# Autodesk Inventor assembly: GR Master
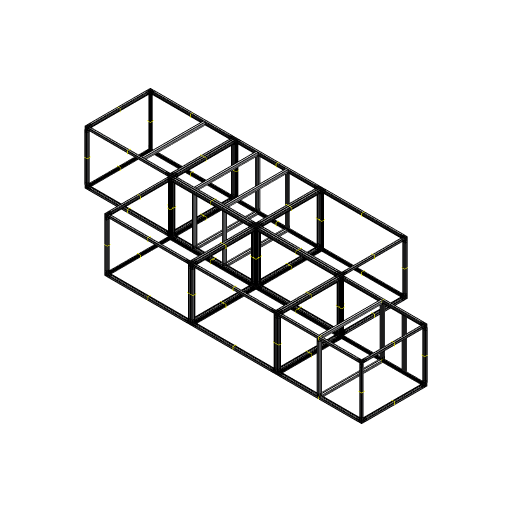
[picture p0: Inventor's stored thumbnail of the model, 512x512]
Saved by Autodesk Inventor 2024.3 (Build 283343000, 343)
## iProperties
Created: 2026-11-19
Part Number: GR Master
Material: Generisch
Document SubType Name: Assembly
Designer: Loay Azzeh
Mass: 149819 g
Surface Area: 673743 cm^2
Volume: 59984.3 cm^3
Density: 2.49763 g/cm^3
Author: Loay Azzeh
## Documents named in this file (8)
- C:\Users\la\Documents\GitHub\Inventor_Sizer\C# Version\GR\20trail20.iam
- C:\Users\la\Documents\GitHub\Inventor_Sizer\APS Ecke Kunststoff.ipt
- C:\Users\la\Documents\GitHub\Inventor_Sizer\Joint.ipt
- C:\Users\la\Documents\GitHub\Inventor_Sizer\P150 2000mm.ipt
- C:\Users\la\Documents\GitHub\Inventor_Sizer\P150 1200mm.ipt
- C:\Users\la\Documents\GitHub\Inventor_Sizer\P150 1500mm.ipt
- C:\Users\la\Documents\GitHub\Inventor_Sizer\P350 1210mm.ipt
- C:\Users\la\Documents\GitHub\Inventor_Sizer\P350 1550mm gefräst.ipt
## Components (146 placed, 7 different names)
1. APS Ecke Kunststoff:1 — Mate:1, Flush:1, Flush:2, Mate:2, Flush:3, Flush:4, Flush:5, Flush:6, Mate:3, Mate:56, Flush:129, Flush:130
2. Joint:1 — Mate:20, Flush:49, Flush:50, Flush:51
3. P150 2000mm:1 — Mate:1, Flush:1, Flush:2, Mate:7, Flush:13, Flush:14, Flush:70, Mate:35, Flush:77, Flush:79, Mate:36
4. P350 1550mm gefräst:1 — Mate:34, Flush:75, Flush:76
5. P350 1210mm:1 — Mate:20, Flush:49, Flush:50, Flush:51, Mate:21, Flush:52, Flush:53, Flush:54, Mate:23, Flush:74, Flush:76, Flush:78
6. P150 1200mm:1 — Mate:2, Flush:3, Flush:4, Mate:23, Mate:31
7. P150 1500mm:1 — Flush:5, Flush:6, Mate:3, Flush:15, Flush:16, Mate:8
8. APS Ecke Kunststoff:2
9. P150 2000mm:2 — Flush:17, Flush:18, Mate:33
10. P150 1200mm:2
11. P150 1500mm:2 — Flush:19, Flush:20
12. APS Ecke Kunststoff:3 — Flush:15, Flush:16, Mate:8, Flush:17, Flush:18, Flush:47, Flush:48
13. APS Ecke Kunststoff:4 — Mate:7, Flush:13, Flush:14, Flush:19, Flush:20, Mate:19, Flush:45, Flush:46, Mate:75, Flush:177, Flush:178
14. APS Ecke Kunststoff:5
15. P150 2000mm:3 — Mate:32, Flush:71, Flush:73, Flush:75, Flush:82
16. P150 1200mm:3 — Flush:47, Flush:48
17. P150 1500mm:3
18. APS Ecke Kunststoff:6
19. P150 2000mm:4 — Mate:22, Flush:54, Mate:30, Mate:34, Mate:37
20. P150 1200mm:4 — Mate:19, Flush:45, Flush:46
21. P150 1500mm:4
22. APS Ecke Kunststoff:7
23. APS Ecke Kunststoff:8
24. Joint:2 — Mate:21, Flush:52, Flush:53, Mate:22
25. Joint:3
26. P350 1210mm:2 — Flush:70, Mate:31, Flush:72, Flush:80
27. Joint:4 — Mate:30
28. Joint:5
29. P350 1210mm:3 — Flush:73, Flush:74
30. Joint:6 — Mate:33
31. Joint:7
32. P350 1210mm:4 — Flush:71, Flush:72, Flush:81
33. Joint:8 — Mate:32
34. P350 1550mm gefräst:2 — Flush:81, Flush:82, Mate:37
35. P350 1550mm gefräst:3 — Mate:35, Flush:77, Flush:78
36. P350 1550mm gefräst:4 — Flush:79, Mate:36, Flush:80
37. APS Ecke Kunststoff:9 — Mate:38, Flush:83, Flush:84, Mate:39, Flush:85, Flush:86, Flush:87, Flush:88, Mate:40
38. P150 2000mm:5 — Mate:38, Flush:83, Flush:84, Mate:44, Flush:95, Flush:96
39. P150 1200mm:5 — Mate:39, Flush:85, Flush:86
40. P150 1500mm:5 — Flush:87, Flush:88, Mate:40, Flush:97, Flush:98, Mate:45
41. APS Ecke Kunststoff:10 — Mate:41, Flush:89, Flush:90, Mate:42, Flush:91, Flush:92, Flush:93, Flush:94, Mate:43
42. P150 2000mm:6 — Mate:41, Flush:89, Flush:90, Flush:99, Flush:100
43. P150 1200mm:6 — Mate:42, Flush:91, Flush:92
44. P150 1500mm:6 — Flush:93, Flush:94, Mate:43, Flush:101, Flush:102
45. APS Ecke Kunststoff:11 — Flush:97, Flush:98, Mate:45, Flush:99, Flush:100, Flush:127, Flush:128
46. APS Ecke Kunststoff:12 — Mate:44, Flush:95, Flush:96, Flush:101, Flush:102, Mate:55, Flush:125, Flush:126, Mate:56, Flush:129, Flush:130
47. APS Ecke Kunststoff:13 — Mate:46, Flush:103, Flush:104, Mate:47, Flush:105, Flush:106, Flush:107, Flush:108, Mate:48
48. P150 2000mm:7 — Mate:46, Flush:103, Flush:104, Mate:52, Flush:115, Flush:116
49. P150 1200mm:7 — Mate:47, Flush:105, Flush:106, Flush:127, Flush:128
50. P150 1500mm:7 — Flush:107, Flush:108, Mate:48, Flush:117, Flush:118, Mate:53
51. APS Ecke Kunststoff:14 — Mate:49, Flush:109, Flush:110, Mate:50, Flush:111, Flush:112, Flush:113, Flush:114, Mate:51, Flush:123, Flush:124
52. P150 2000mm:8 — Mate:49, Flush:109, Flush:110, Mate:54, Flush:119, Flush:120
53. P150 1200mm:8 — Mate:50, Flush:111, Flush:112, Flush:123, Flush:124, Mate:55, Flush:125, Flush:126
54. P150 1500mm:8 — Flush:113, Flush:114, Mate:51, Flush:121, Flush:122
55. APS Ecke Kunststoff:15 — Flush:117, Flush:118, Mate:53, Mate:54, Flush:119, Flush:120
56. APS Ecke Kunststoff:16 — Mate:52, Flush:115, Flush:116, Flush:121, Flush:122
57. APS Ecke Kunststoff:17 — Mate:57, Flush:131, Flush:132, Mate:58, Flush:133, Flush:134, Flush:135, Flush:136, Mate:59, Mate:75, Flush:177, Flush:178, Mate:94, Flush:225, Flush:226
58. P150 2000mm:9 — Mate:57, Flush:131, Flush:132, Mate:63, Flush:143, Flush:144
59. P150 1200mm:9 — Mate:58, Flush:133, Flush:134
60. P150 1500mm:9 — Flush:135, Flush:136, Mate:59, Flush:145, Flush:146, Mate:64
61. APS Ecke Kunststoff:18 — Mate:60, Flush:137, Flush:138, Mate:61, Flush:139, Flush:140, Flush:141, Flush:142, Mate:62
62. P150 2000mm:10 — Mate:60, Flush:137, Flush:138, Flush:147, Flush:148
63. P150 1200mm:10 — Mate:61, Flush:139, Flush:140
64. P150 1500mm:10 — Flush:141, Flush:142, Mate:62, Flush:149, Flush:150
65. APS Ecke Kunststoff:19 — Flush:145, Flush:146, Mate:64, Flush:147, Flush:148, Flush:175, Flush:176
66. APS Ecke Kunststoff:20 — Mate:63, Flush:143, Flush:144, Flush:149, Flush:150, Mate:74, Flush:173, Flush:174
67. APS Ecke Kunststoff:21 — Mate:65, Flush:151, Flush:152, Mate:66, Flush:153, Flush:154, Flush:155, Flush:156, Mate:67
68. P150 2000mm:11 — Mate:65, Flush:151, Flush:152, Mate:71, Flush:163, Flush:164
69. P150 1200mm:11 — Mate:66, Flush:153, Flush:154, Flush:175, Flush:176
70. P150 1500mm:11 — Flush:155, Flush:156, Mate:67, Flush:165, Flush:166, Mate:72
71. APS Ecke Kunststoff:22 — Mate:68, Flush:157, Flush:158, Mate:69, Flush:159, Flush:160, Flush:161, Flush:162, Mate:70, Flush:171, Flush:172
72. P150 2000mm:12 — Mate:68, Flush:157, Flush:158, Mate:73, Flush:167, Flush:168
73. P150 1200mm:12 — Mate:69, Flush:159, Flush:160, Flush:171, Flush:172, Mate:74, Flush:173, Flush:174
74. P150 1500mm:12 — Flush:161, Flush:162, Mate:70, Flush:169, Flush:170
75. APS Ecke Kunststoff:23 — Flush:165, Flush:166, Mate:72, Mate:73, Flush:167, Flush:168
76. APS Ecke Kunststoff:24 — Mate:71, Flush:163, Flush:164, Flush:169, Flush:170
77. APS Ecke Kunststoff:25 — Mate:76, Flush:179, Flush:180, Mate:77, Flush:181, Flush:182, Flush:183, Flush:184, Mate:78, Mate:132, Flush:321, Flush:322
78. P150 2000mm:13 — Mate:76, Flush:179, Flush:180, Mate:82, Flush:191, Flush:192
79. P150 1200mm:13 — Mate:77, Flush:181, Flush:182
80. P150 1500mm:13 — Flush:183, Flush:184, Mate:78, Flush:193, Flush:194, Mate:83
81. APS Ecke Kunststoff:26 — Mate:79, Flush:185, Flush:186, Mate:80, Flush:187, Flush:188, Flush:189, Flush:190, Mate:81
82. P150 2000mm:14 — Mate:79, Flush:185, Flush:186, Flush:195, Flush:196
83. P150 1200mm:14 — Mate:80, Flush:187, Flush:188
84. P150 1500mm:14 — Flush:189, Flush:190, Mate:81, Flush:197, Flush:198
85. APS Ecke Kunststoff:27 — Flush:193, Flush:194, Mate:83, Flush:195, Flush:196, Flush:223, Flush:224, Mate:94, Flush:225, Flush:226
86. APS Ecke Kunststoff:28 — Mate:82, Flush:191, Flush:192, Flush:197, Flush:198, Mate:93, Flush:221, Flush:222, Mate:113, Flush:273, Flush:274
87. APS Ecke Kunststoff:29 — Mate:84, Flush:199, Flush:200, Mate:85, Flush:201, Flush:202, Flush:203, Flush:204, Mate:86
88. P150 2000mm:15 — Mate:84, Flush:199, Flush:200, Mate:90, Flush:211, Flush:212
89. P150 1200mm:15 — Mate:85, Flush:201, Flush:202, Flush:223, Flush:224
90. P150 1500mm:15 — Flush:203, Flush:204, Mate:86, Flush:213, Flush:214, Mate:91
91. APS Ecke Kunststoff:30 — Mate:87, Flush:205, Flush:206, Mate:88, Flush:207, Flush:208, Flush:209, Flush:210, Mate:89, Flush:219, Flush:220
92. P150 2000mm:16 — Mate:87, Flush:205, Flush:206, Mate:92, Flush:215, Flush:216
93. P150 1200mm:16 — Mate:88, Flush:207, Flush:208, Flush:219, Flush:220, Mate:93, Flush:221, Flush:222
94. P150 1500mm:16 — Flush:209, Flush:210, Mate:89, Flush:217, Flush:218
95. APS Ecke Kunststoff:31 — Flush:213, Flush:214, Mate:91, Mate:92, Flush:215, Flush:216
96. APS Ecke Kunststoff:32 — Mate:90, Flush:211, Flush:212, Flush:217, Flush:218
97. APS Ecke Kunststoff:33 — Mate:95, Flush:227, Flush:228, Mate:96, Flush:229, Flush:230, Flush:231, Flush:232, Mate:97, Mate:113, Flush:273, Flush:274
98. P150 2000mm:17 — Mate:95, Flush:227, Flush:228, Mate:101, Flush:239, Flush:240, Mate:141, Flush:338
99. P150 1200mm:17 — Mate:96, Flush:229, Flush:230, Mate:136
100. P150 1500mm:17 — Flush:231, Flush:232, Mate:97, Flush:241, Flush:242, Mate:102
101. APS Ecke Kunststoff:34 — Mate:98, Flush:233, Flush:234, Mate:99, Flush:235, Flush:236, Flush:237, Flush:238, Mate:100
102. P150 2000mm:18 — Mate:98, Flush:233, Flush:234, Flush:243, Flush:244, Mate:139
103. P150 1200mm:18 — Mate:99, Flush:235, Flush:236
104. P150 1500mm:18 — Flush:237, Flush:238, Mate:100, Flush:245, Flush:246
105. APS Ecke Kunststoff:35 — Flush:241, Flush:242, Mate:102, Flush:243, Flush:244, Flush:271, Flush:272
106. APS Ecke Kunststoff:36 — Mate:101, Flush:239, Flush:240, Flush:245, Flush:246, Mate:112, Flush:269, Flush:270
107. APS Ecke Kunststoff:37 — Mate:103, Flush:247, Flush:248, Mate:104, Flush:249, Flush:250, Flush:251, Flush:252, Mate:105
108. P150 2000mm:19 — Mate:103, Flush:247, Flush:248, Mate:109, Flush:259, Flush:260, Flush:334, Flush:336
109. P150 1200mm:19 — Mate:104, Flush:249, Flush:250, Flush:271, Flush:272
110. P150 1500mm:19 — Flush:251, Flush:252, Mate:105, Flush:261, Flush:262, Mate:110
111. APS Ecke Kunststoff:38 — Mate:106, Flush:253, Flush:254, Mate:107, Flush:255, Flush:256, Flush:257, Flush:258, Mate:108, Flush:267, Flush:268
112. P150 2000mm:20 — Mate:106, Flush:253, Flush:254, Mate:111, Flush:263, Flush:264, Mate:135, Flush:328, Mate:140
113. P150 1200mm:20 — Mate:107, Flush:255, Flush:256, Flush:267, Flush:268, Mate:112, Flush:269, Flush:270
114. P150 1500mm:20 — Flush:257, Flush:258, Mate:108, Flush:265, Flush:266
115. APS Ecke Kunststoff:39 — Flush:261, Flush:262, Mate:110, Mate:111, Flush:263, Flush:264
116. APS Ecke Kunststoff:40 — Mate:109, Flush:259, Flush:260, Flush:265, Flush:266
117. APS Ecke Kunststoff:41 — Mate:114, Flush:275, Flush:276, Mate:115, Flush:277, Flush:278, Flush:279, Flush:280, Mate:116
118. P150 2000mm:21 — Mate:114, Flush:275, Flush:276, Mate:120, Flush:287, Flush:288
119. P150 1200mm:21 — Mate:115, Flush:277, Flush:278
120. P150 1500mm:21 — Flush:279, Flush:280, Mate:116, Flush:289, Flush:290, Mate:121
121. APS Ecke Kunststoff:42 — Mate:117, Flush:281, Flush:282, Mate:118, Flush:283, Flush:284, Flush:285, Flush:286, Mate:119
122. P150 2000mm:22 — Mate:117, Flush:281, Flush:282, Flush:291, Flush:292
123. P150 1200mm:22 — Mate:118, Flush:283, Flush:284
124. P150 1500mm:22 — Flush:285, Flush:286, Mate:119, Flush:293, Flush:294
125. APS Ecke Kunststoff:43 — Flush:289, Flush:290, Mate:121, Flush:291, Flush:292, Flush:319, Flush:320
126. APS Ecke Kunststoff:44 — Mate:120, Flush:287, Flush:288, Flush:293, Flush:294, Mate:131, Flush:317, Flush:318, Mate:132, Flush:321, Flush:322
127. APS Ecke Kunststoff:45 — Mate:122, Flush:295, Flush:296, Mate:123, Flush:297, Flush:298, Flush:299, Flush:300, Mate:124
128. P150 2000mm:23 — Mate:122, Flush:295, Flush:296, Mate:128, Flush:307, Flush:308
129. P150 1200mm:23 — Mate:123, Flush:297, Flush:298, Flush:319, Flush:320
130. P150 1500mm:23 — Flush:299, Flush:300, Mate:124, Flush:309, Flush:310, Mate:129
131. APS Ecke Kunststoff:46 — Mate:125, Flush:301, Flush:302, Mate:126, Flush:303, Flush:304, Flush:305, Flush:306, Mate:127, Flush:315, Flush:316
132. P150 2000mm:24 — Mate:125, Flush:301, Flush:302, Mate:130, Flush:311, Flush:312
133. P150 1200mm:24 — Mate:126, Flush:303, Flush:304, Flush:315, Flush:316, Mate:131, Flush:317, Flush:318
134. P150 1500mm:24 — Flush:305, Flush:306, Mate:127, Flush:313, Flush:314
135. APS Ecke Kunststoff:47 — Flush:309, Flush:310, Mate:129, Mate:130, Flush:311, Flush:312
136. APS Ecke Kunststoff:48 — Mate:128, Flush:307, Flush:308, Flush:313, Flush:314
137. P350 1210mm:5 — Mate:133, Flush:323, Flush:324, Flush:325, Mate:134, Flush:326, Flush:327, Flush:328, Mate:136, Flush:335, Flush:337, Flush:339
138. P350 1210mm:6 — Mate:137, Flush:329, Flush:330, Flush:331, Mate:138, Flush:332, Flush:333, Flush:334, Flush:335
139. P350 1550mm gefräst:5 — Mate:140, Flush:336, Flush:337
140. P350 1550mm gefräst:6 — Mate:141, Flush:338, Flush:339
141. Joint:9 — Mate:133, Flush:323, Flush:324, Flush:325
142. Joint:10 — Mate:134, Flush:326, Flush:327, Mate:135
143. Joint:11 — Mate:137, Flush:329, Flush:330, Flush:331
144. Joint:12 — Mate:138, Flush:332, Flush:333, Mate:139
145. P350 1210mm:7
146. P350 1550mm gefräst:7
## Relationships (477: Flush 337, Mate 140)
- Mate:1: APS Ecke Kunststoff:1 ↔ P150 2000mm:1
- Flush:1: APS Ecke Kunststoff:1 ↔ P150 2000mm:1
- Flush:2: APS Ecke Kunststoff:1 ↔ P150 2000mm:1
- Mate:2: APS Ecke Kunststoff:1 ↔ P150 1200mm:1
- Flush:3: APS Ecke Kunststoff:1 ↔ P150 1200mm:1
- Flush:4: APS Ecke Kunststoff:1 ↔ P150 1200mm:1
- Flush:5: APS Ecke Kunststoff:1 ↔ P150 1500mm:1
- Flush:6: APS Ecke Kunststoff:1 ↔ P150 1500mm:1
- Mate:3: APS Ecke Kunststoff:1 ↔ P150 1500mm:1
- [Mate]: APS Ecke Kunststoff:2 ↔ P150 2000mm:2
- [Flush]: APS Ecke Kunststoff:2 ↔ P150 2000mm:2
- [Flush]: APS Ecke Kunststoff:2 ↔ P150 2000mm:2
- [Mate]: APS Ecke Kunststoff:2 ↔ P150 1200mm:2
- [Flush]: APS Ecke Kunststoff:2 ↔ P150 1200mm:2
- [Flush]: APS Ecke Kunststoff:2 ↔ P150 1200mm:2
- [Flush]: APS Ecke Kunststoff:2 ↔ P150 1500mm:2
- [Flush]: APS Ecke Kunststoff:2 ↔ P150 1500mm:2
- [Mate]: APS Ecke Kunststoff:2 ↔ P150 1500mm:2
- Mate:7: P150 2000mm:1 ↔ APS Ecke Kunststoff:4
- Flush:13: P150 2000mm:1 ↔ APS Ecke Kunststoff:4
- Flush:14: P150 2000mm:1 ↔ APS Ecke Kunststoff:4
- Flush:15: P150 1500mm:1 ↔ APS Ecke Kunststoff:3
- Flush:16: P150 1500mm:1 ↔ APS Ecke Kunststoff:3
- Mate:8: P150 1500mm:1 ↔ APS Ecke Kunststoff:3
- Flush:17: P150 2000mm:2 ↔ APS Ecke Kunststoff:3
- Flush:18: P150 2000mm:2 ↔ APS Ecke Kunststoff:3
- Flush:19: P150 1500mm:2 ↔ APS Ecke Kunststoff:4
- Flush:20: P150 1500mm:2 ↔ APS Ecke Kunststoff:4
- [Mate]: APS Ecke Kunststoff:5 ↔ P150 2000mm:3
- [Flush]: APS Ecke Kunststoff:5 ↔ P150 2000mm:3
- [Flush]: APS Ecke Kunststoff:5 ↔ P150 2000mm:3
- [Mate]: APS Ecke Kunststoff:5 ↔ P150 1200mm:3
- [Flush]: APS Ecke Kunststoff:5 ↔ P150 1200mm:3
- [Flush]: APS Ecke Kunststoff:5 ↔ P150 1200mm:3
- [Flush]: APS Ecke Kunststoff:5 ↔ P150 1500mm:3
- [Flush]: APS Ecke Kunststoff:5 ↔ P150 1500mm:3
- [Mate]: APS Ecke Kunststoff:5 ↔ P150 1500mm:3
- [Mate]: APS Ecke Kunststoff:6 ↔ P150 2000mm:4
- [Flush]: APS Ecke Kunststoff:6 ↔ P150 2000mm:4
- [Flush]: APS Ecke Kunststoff:6 ↔ P150 2000mm:4
- [Mate]: APS Ecke Kunststoff:6 ↔ P150 1200mm:4
- [Flush]: APS Ecke Kunststoff:6 ↔ P150 1200mm:4
- [Flush]: APS Ecke Kunststoff:6 ↔ P150 1200mm:4
- [Flush]: APS Ecke Kunststoff:6 ↔ P150 1500mm:4
- [Flush]: APS Ecke Kunststoff:6 ↔ P150 1500mm:4
- [Mate]: APS Ecke Kunststoff:6 ↔ P150 1500mm:4
- [Mate]: P150 2000mm:3 ↔ APS Ecke Kunststoff:8
- [Flush]: P150 2000mm:3 ↔ APS Ecke Kunststoff:8
- [Flush]: P150 2000mm:3 ↔ APS Ecke Kunststoff:8
- [Flush]: P150 1500mm:3 ↔ APS Ecke Kunststoff:7
- [Flush]: P150 1500mm:3 ↔ APS Ecke Kunststoff:7
- [Mate]: P150 1500mm:3 ↔ APS Ecke Kunststoff:7
- [Mate]: P150 2000mm:4 ↔ APS Ecke Kunststoff:7
- [Flush]: P150 2000mm:4 ↔ APS Ecke Kunststoff:7
- [Flush]: P150 2000mm:4 ↔ APS Ecke Kunststoff:7
- [Flush]: P150 1500mm:4 ↔ APS Ecke Kunststoff:8
- [Flush]: P150 1500mm:4 ↔ APS Ecke Kunststoff:8
- [Flush]: APS Ecke Kunststoff:6 ↔ P150 1200mm:4
- [Flush]: APS Ecke Kunststoff:6 ↔ P150 1200mm:4
- Mate:19: APS Ecke Kunststoff:4 ↔ P150 1200mm:4
- Flush:45: APS Ecke Kunststoff:4 ↔ P150 1200mm:4
- Flush:46: APS Ecke Kunststoff:4 ↔ P150 1200mm:4
- Flush:47: APS Ecke Kunststoff:3 ↔ P150 1200mm:3
- Flush:48: APS Ecke Kunststoff:3 ↔ P150 1200mm:3
- Mate:20: Joint:1 ↔ P350 1210mm:1
- Flush:49: Joint:1 ↔ P350 1210mm:1
- Flush:50: Joint:1 ↔ P350 1210mm:1
- Flush:51: Joint:1 ↔ P350 1210mm:1
- Mate:21: P350 1210mm:1 ↔ Joint:2
- Flush:52: P350 1210mm:1 ↔ Joint:2
- Flush:53: P350 1210mm:1 ↔ Joint:2
- Mate:22: P150 2000mm:4 ↔ Joint:2
- Flush:54: P350 1210mm:1 ↔ P150 2000mm:4
- Mate:23 (500 mm): P350 1210mm:1 ↔ P150 1200mm:1
- [Mate]: Joint:3 ↔ P350 1210mm:2
- [Flush]: Joint:3 ↔ P350 1210mm:2
- [Flush]: Joint:3 ↔ P350 1210mm:2
- [Flush]: Joint:3 ↔ P350 1210mm:2
- [Mate]: P350 1210mm:2 ↔ Joint:4
- [Flush]: P350 1210mm:2 ↔ Joint:4
- [Flush]: P350 1210mm:2 ↔ Joint:4
- [Mate]: Joint:5 ↔ P350 1210mm:3
- [Flush]: Joint:5 ↔ P350 1210mm:3
- [Flush]: Joint:5 ↔ P350 1210mm:3
- [Flush]: Joint:5 ↔ P350 1210mm:3
- [Mate]: P350 1210mm:3 ↔ Joint:6
- [Flush]: P350 1210mm:3 ↔ Joint:6
- [Flush]: P350 1210mm:3 ↔ Joint:6
- [Mate]: Joint:7 ↔ P350 1210mm:4
- [Flush]: Joint:7 ↔ P350 1210mm:4
- [Flush]: Joint:7 ↔ P350 1210mm:4
- [Flush]: Joint:7 ↔ P350 1210mm:4
- [Mate]: P350 1210mm:4 ↔ Joint:8
- [Flush]: P350 1210mm:4 ↔ Joint:8
- [Flush]: P350 1210mm:4 ↔ Joint:8
- Mate:30: P150 2000mm:4 ↔ Joint:4
- Flush:70: P150 2000mm:1 ↔ P350 1210mm:2
- Mate:31 (1250 mm): P150 1200mm:1 ↔ P350 1210mm:2
- Mate:32: P150 2000mm:3 ↔ Joint:8
- Flush:71: P150 2000mm:3 ↔ P350 1210mm:4
- Flush:72: P350 1210mm:2 ↔ P350 1210mm:4
- Flush:73: P150 2000mm:3 ↔ P350 1210mm:3
- Flush:74: P350 1210mm:1 ↔ P350 1210mm:3
- Mate:33: P150 2000mm:2 ↔ Joint:6
- Mate:34: P350 1550mm gefräst:1 ↔ P150 2000mm:4
- Flush:75: P350 1550mm gefräst:1 ↔ P150 2000mm:3
- Flush:76: P350 1550mm gefräst:1 ↔ P350 1210mm:1
- Mate:35: P150 2000mm:1 ↔ P350 1550mm gefräst:3
- Flush:77: P150 2000mm:1 ↔ P350 1550mm gefräst:3
- Flush:78: P350 1210mm:1 ↔ P350 1550mm gefräst:3
- Flush:79: P150 2000mm:1 ↔ P350 1550mm gefräst:4
- Mate:36: P150 2000mm:1 ↔ P350 1550mm gefräst:4
- Flush:80: P350 1210mm:2 ↔ P350 1550mm gefräst:4
- Flush:81: P350 1210mm:4 ↔ P350 1550mm gefräst:2
- Flush:82: P150 2000mm:3 ↔ P350 1550mm gefräst:2
- Mate:37: P150 2000mm:4 ↔ P350 1550mm gefräst:2
- Mate:38: APS Ecke Kunststoff:9 ↔ P150 2000mm:5
- Flush:83: APS Ecke Kunststoff:9 ↔ P150 2000mm:5
- Flush:84: APS Ecke Kunststoff:9 ↔ P150 2000mm:5
- Mate:39: APS Ecke Kunststoff:9 ↔ P150 1200mm:5
- Flush:85: APS Ecke Kunststoff:9 ↔ P150 1200mm:5
- Flush:86: APS Ecke Kunststoff:9 ↔ P150 1200mm:5
- Flush:87: APS Ecke Kunststoff:9 ↔ P150 1500mm:5
- Flush:88: APS Ecke Kunststoff:9 ↔ P150 1500mm:5
- Mate:40: APS Ecke Kunststoff:9 ↔ P150 1500mm:5
- Mate:41: APS Ecke Kunststoff:10 ↔ P150 2000mm:6
- Flush:89: APS Ecke Kunststoff:10 ↔ P150 2000mm:6
- Flush:90: APS Ecke Kunststoff:10 ↔ P150 2000mm:6
- Mate:42: APS Ecke Kunststoff:10 ↔ P150 1200mm:6
- Flush:91: APS Ecke Kunststoff:10 ↔ P150 1200mm:6
- Flush:92: APS Ecke Kunststoff:10 ↔ P150 1200mm:6
- Flush:93: APS Ecke Kunststoff:10 ↔ P150 1500mm:6
- Flush:94: APS Ecke Kunststoff:10 ↔ P150 1500mm:6
- Mate:43: APS Ecke Kunststoff:10 ↔ P150 1500mm:6
- Mate:44: P150 2000mm:5 ↔ APS Ecke Kunststoff:12
- Flush:95: P150 2000mm:5 ↔ APS Ecke Kunststoff:12
- Flush:96: P150 2000mm:5 ↔ APS Ecke Kunststoff:12
- Flush:97: P150 1500mm:5 ↔ APS Ecke Kunststoff:11
- Flush:98: P150 1500mm:5 ↔ APS Ecke Kunststoff:11
- Mate:45: P150 1500mm:5 ↔ APS Ecke Kunststoff:11
- Flush:99: P150 2000mm:6 ↔ APS Ecke Kunststoff:11
- Flush:100: P150 2000mm:6 ↔ APS Ecke Kunststoff:11
- Flush:101: P150 1500mm:6 ↔ APS Ecke Kunststoff:12
- Flush:102: P150 1500mm:6 ↔ APS Ecke Kunststoff:12
- Mate:46: APS Ecke Kunststoff:13 ↔ P150 2000mm:7
- Flush:103: APS Ecke Kunststoff:13 ↔ P150 2000mm:7
- Flush:104: APS Ecke Kunststoff:13 ↔ P150 2000mm:7
- Mate:47: APS Ecke Kunststoff:13 ↔ P150 1200mm:7
- Flush:105: APS Ecke Kunststoff:13 ↔ P150 1200mm:7
- Flush:106: APS Ecke Kunststoff:13 ↔ P150 1200mm:7
- Flush:107: APS Ecke Kunststoff:13 ↔ P150 1500mm:7
- Flush:108: APS Ecke Kunststoff:13 ↔ P150 1500mm:7
- Mate:48: APS Ecke Kunststoff:13 ↔ P150 1500mm:7
- Mate:49: APS Ecke Kunststoff:14 ↔ P150 2000mm:8
- Flush:109: APS Ecke Kunststoff:14 ↔ P150 2000mm:8
- Flush:110: APS Ecke Kunststoff:14 ↔ P150 2000mm:8
- Mate:50: APS Ecke Kunststoff:14 ↔ P150 1200mm:8
- Flush:111: APS Ecke Kunststoff:14 ↔ P150 1200mm:8
- Flush:112: APS Ecke Kunststoff:14 ↔ P150 1200mm:8
- Flush:113: APS Ecke Kunststoff:14 ↔ P150 1500mm:8
- Flush:114: APS Ecke Kunststoff:14 ↔ P150 1500mm:8
- Mate:51: APS Ecke Kunststoff:14 ↔ P150 1500mm:8
- Mate:52: P150 2000mm:7 ↔ APS Ecke Kunststoff:16
- Flush:115: P150 2000mm:7 ↔ APS Ecke Kunststoff:16
- Flush:116: P150 2000mm:7 ↔ APS Ecke Kunststoff:16
- Flush:117: P150 1500mm:7 ↔ APS Ecke Kunststoff:15
- Flush:118: P150 1500mm:7 ↔ APS Ecke Kunststoff:15
- Mate:53: P150 1500mm:7 ↔ APS Ecke Kunststoff:15
- Mate:54: P150 2000mm:8 ↔ APS Ecke Kunststoff:15
- Flush:119: P150 2000mm:8 ↔ APS Ecke Kunststoff:15
- Flush:120: P150 2000mm:8 ↔ APS Ecke Kunststoff:15
- Flush:121: P150 1500mm:8 ↔ APS Ecke Kunststoff:16
- Flush:122: P150 1500mm:8 ↔ APS Ecke Kunststoff:16
- Flush:123: APS Ecke Kunststoff:14 ↔ P150 1200mm:8
- Flush:124: APS Ecke Kunststoff:14 ↔ P150 1200mm:8
- Mate:55: APS Ecke Kunststoff:12 ↔ P150 1200mm:8
- Flush:125: APS Ecke Kunststoff:12 ↔ P150 1200mm:8
- Flush:126: APS Ecke Kunststoff:12 ↔ P150 1200mm:8
- Flush:127: APS Ecke Kunststoff:11 ↔ P150 1200mm:7
- Flush:128: APS Ecke Kunststoff:11 ↔ P150 1200mm:7
- Mate:56: APS Ecke Kunststoff:1 ↔ APS Ecke Kunststoff:12
- Flush:129: APS Ecke Kunststoff:1 ↔ APS Ecke Kunststoff:12
- Flush:130: APS Ecke Kunststoff:1 ↔ APS Ecke Kunststoff:12
- Mate:57: APS Ecke Kunststoff:17 ↔ P150 2000mm:9
- Flush:131: APS Ecke Kunststoff:17 ↔ P150 2000mm:9
- Flush:132: APS Ecke Kunststoff:17 ↔ P150 2000mm:9
- Mate:58: APS Ecke Kunststoff:17 ↔ P150 1200mm:9
- Flush:133: APS Ecke Kunststoff:17 ↔ P150 1200mm:9
- Flush:134: APS Ecke Kunststoff:17 ↔ P150 1200mm:9
- Flush:135: APS Ecke Kunststoff:17 ↔ P150 1500mm:9
- Flush:136: APS Ecke Kunststoff:17 ↔ P150 1500mm:9
- Mate:59: APS Ecke Kunststoff:17 ↔ P150 1500mm:9
- Mate:60: APS Ecke Kunststoff:18 ↔ P150 2000mm:10
- Flush:137: APS Ecke Kunststoff:18 ↔ P150 2000mm:10
- Flush:138: APS Ecke Kunststoff:18 ↔ P150 2000mm:10
- Mate:61: APS Ecke Kunststoff:18 ↔ P150 1200mm:10
- Flush:139: APS Ecke Kunststoff:18 ↔ P150 1200mm:10
- Flush:140: APS Ecke Kunststoff:18 ↔ P150 1200mm:10
- Flush:141: APS Ecke Kunststoff:18 ↔ P150 1500mm:10
- Flush:142: APS Ecke Kunststoff:18 ↔ P150 1500mm:10
- Mate:62: APS Ecke Kunststoff:18 ↔ P150 1500mm:10
- Mate:63: P150 2000mm:9 ↔ APS Ecke Kunststoff:20
- Flush:143: P150 2000mm:9 ↔ APS Ecke Kunststoff:20
- Flush:144: P150 2000mm:9 ↔ APS Ecke Kunststoff:20
- Flush:145: P150 1500mm:9 ↔ APS Ecke Kunststoff:19
- Flush:146: P150 1500mm:9 ↔ APS Ecke Kunststoff:19
- Mate:64: P150 1500mm:9 ↔ APS Ecke Kunststoff:19
- Flush:147: P150 2000mm:10 ↔ APS Ecke Kunststoff:19
- Flush:148: P150 2000mm:10 ↔ APS Ecke Kunststoff:19
- Flush:149: P150 1500mm:10 ↔ APS Ecke Kunststoff:20
- Flush:150: P150 1500mm:10 ↔ APS Ecke Kunststoff:20
- Mate:65: APS Ecke Kunststoff:21 ↔ P150 2000mm:11
- Flush:151: APS Ecke Kunststoff:21 ↔ P150 2000mm:11
- Flush:152: APS Ecke Kunststoff:21 ↔ P150 2000mm:11
- Mate:66: APS Ecke Kunststoff:21 ↔ P150 1200mm:11
- Flush:153: APS Ecke Kunststoff:21 ↔ P150 1200mm:11
- Flush:154: APS Ecke Kunststoff:21 ↔ P150 1200mm:11
- Flush:155: APS Ecke Kunststoff:21 ↔ P150 1500mm:11
- Flush:156: APS Ecke Kunststoff:21 ↔ P150 1500mm:11
- Mate:67: APS Ecke Kunststoff:21 ↔ P150 1500mm:11
- Mate:68: APS Ecke Kunststoff:22 ↔ P150 2000mm:12
- Flush:157: APS Ecke Kunststoff:22 ↔ P150 2000mm:12
- Flush:158: APS Ecke Kunststoff:22 ↔ P150 2000mm:12
- Mate:69: APS Ecke Kunststoff:22 ↔ P150 1200mm:12
- Flush:159: APS Ecke Kunststoff:22 ↔ P150 1200mm:12
- Flush:160: APS Ecke Kunststoff:22 ↔ P150 1200mm:12
- Flush:161: APS Ecke Kunststoff:22 ↔ P150 1500mm:12
- Flush:162: APS Ecke Kunststoff:22 ↔ P150 1500mm:12
- Mate:70: APS Ecke Kunststoff:22 ↔ P150 1500mm:12
- Mate:71: P150 2000mm:11 ↔ APS Ecke Kunststoff:24
- Flush:163: P150 2000mm:11 ↔ APS Ecke Kunststoff:24
- Flush:164: P150 2000mm:11 ↔ APS Ecke Kunststoff:24
- Flush:165: P150 1500mm:11 ↔ APS Ecke Kunststoff:23
- Flush:166: P150 1500mm:11 ↔ APS Ecke Kunststoff:23
- Mate:72: P150 1500mm:11 ↔ APS Ecke Kunststoff:23
- Mate:73: P150 2000mm:12 ↔ APS Ecke Kunststoff:23
- Flush:167: P150 2000mm:12 ↔ APS Ecke Kunststoff:23
- Flush:168: P150 2000mm:12 ↔ APS Ecke Kunststoff:23
- Flush:169: P150 1500mm:12 ↔ APS Ecke Kunststoff:24
- Flush:170: P150 1500mm:12 ↔ APS Ecke Kunststoff:24
- Flush:171: APS Ecke Kunststoff:22 ↔ P150 1200mm:12
- Flush:172: APS Ecke Kunststoff:22 ↔ P150 1200mm:12
- Mate:74: APS Ecke Kunststoff:20 ↔ P150 1200mm:12
- Flush:173: APS Ecke Kunststoff:20 ↔ P150 1200mm:12
- Flush:174: APS Ecke Kunststoff:20 ↔ P150 1200mm:12
- Flush:175: APS Ecke Kunststoff:19 ↔ P150 1200mm:11
- Flush:176: APS Ecke Kunststoff:19 ↔ P150 1200mm:11
- Mate:75: APS Ecke Kunststoff:4 ↔ APS Ecke Kunststoff:17
- Flush:177: APS Ecke Kunststoff:4 ↔ APS Ecke Kunststoff:17
- Flush:178: APS Ecke Kunststoff:4 ↔ APS Ecke Kunststoff:17
- Mate:76: APS Ecke Kunststoff:25 ↔ P150 2000mm:13
- Flush:179: APS Ecke Kunststoff:25 ↔ P150 2000mm:13
- Flush:180: APS Ecke Kunststoff:25 ↔ P150 2000mm:13
- Mate:77: APS Ecke Kunststoff:25 ↔ P150 1200mm:13
- Flush:181: APS Ecke Kunststoff:25 ↔ P150 1200mm:13
- Flush:182: APS Ecke Kunststoff:25 ↔ P150 1200mm:13
- Flush:183: APS Ecke Kunststoff:25 ↔ P150 1500mm:13
- Flush:184: APS Ecke Kunststoff:25 ↔ P150 1500mm:13
- Mate:78: APS Ecke Kunststoff:25 ↔ P150 1500mm:13
- Mate:79: APS Ecke Kunststoff:26 ↔ P150 2000mm:14
- Flush:185: APS Ecke Kunststoff:26 ↔ P150 2000mm:14
- Flush:186: APS Ecke Kunststoff:26 ↔ P150 2000mm:14
- Mate:80: APS Ecke Kunststoff:26 ↔ P150 1200mm:14
- Flush:187: APS Ecke Kunststoff:26 ↔ P150 1200mm:14
- Flush:188: APS Ecke Kunststoff:26 ↔ P150 1200mm:14
- Flush:189: APS Ecke Kunststoff:26 ↔ P150 1500mm:14
- Flush:190: APS Ecke Kunststoff:26 ↔ P150 1500mm:14
- Mate:81: APS Ecke Kunststoff:26 ↔ P150 1500mm:14
- Mate:82: P150 2000mm:13 ↔ APS Ecke Kunststoff:28
- Flush:191: P150 2000mm:13 ↔ APS Ecke Kunststoff:28
- Flush:192: P150 2000mm:13 ↔ APS Ecke Kunststoff:28
- Flush:193: P150 1500mm:13 ↔ APS Ecke Kunststoff:27
- Flush:194: P150 1500mm:13 ↔ APS Ecke Kunststoff:27
- Mate:83: P150 1500mm:13 ↔ APS Ecke Kunststoff:27
- Flush:195: P150 2000mm:14 ↔ APS Ecke Kunststoff:27
- Flush:196: P150 2000mm:14 ↔ APS Ecke Kunststoff:27
- Flush:197: P150 1500mm:14 ↔ APS Ecke Kunststoff:28
- Flush:198: P150 1500mm:14 ↔ APS Ecke Kunststoff:28
- Mate:84: APS Ecke Kunststoff:29 ↔ P150 2000mm:15
- Flush:199: APS Ecke Kunststoff:29 ↔ P150 2000mm:15
- Flush:200: APS Ecke Kunststoff:29 ↔ P150 2000mm:15
- Mate:85: APS Ecke Kunststoff:29 ↔ P150 1200mm:15
- Flush:201: APS Ecke Kunststoff:29 ↔ P150 1200mm:15
- Flush:202: APS Ecke Kunststoff:29 ↔ P150 1200mm:15
- Flush:203: APS Ecke Kunststoff:29 ↔ P150 1500mm:15
- Flush:204: APS Ecke Kunststoff:29 ↔ P150 1500mm:15
- Mate:86: APS Ecke Kunststoff:29 ↔ P150 1500mm:15
- Mate:87: APS Ecke Kunststoff:30 ↔ P150 2000mm:16
- Flush:205: APS Ecke Kunststoff:30 ↔ P150 2000mm:16
- Flush:206: APS Ecke Kunststoff:30 ↔ P150 2000mm:16
- Mate:88: APS Ecke Kunststoff:30 ↔ P150 1200mm:16
- Flush:207: APS Ecke Kunststoff:30 ↔ P150 1200mm:16
- Flush:208: APS Ecke Kunststoff:30 ↔ P150 1200mm:16
- Flush:209: APS Ecke Kunststoff:30 ↔ P150 1500mm:16
- Flush:210: APS Ecke Kunststoff:30 ↔ P150 1500mm:16
- Mate:89: APS Ecke Kunststoff:30 ↔ P150 1500mm:16
- Mate:90: P150 2000mm:15 ↔ APS Ecke Kunststoff:32
- Flush:211: P150 2000mm:15 ↔ APS Ecke Kunststoff:32
- Flush:212: P150 2000mm:15 ↔ APS Ecke Kunststoff:32
- Flush:213: P150 1500mm:15 ↔ APS Ecke Kunststoff:31
- Flush:214: P150 1500mm:15 ↔ APS Ecke Kunststoff:31
- Mate:91: P150 1500mm:15 ↔ APS Ecke Kunststoff:31
- Mate:92: P150 2000mm:16 ↔ APS Ecke Kunststoff:31
- Flush:215: P150 2000mm:16 ↔ APS Ecke Kunststoff:31
- Flush:216: P150 2000mm:16 ↔ APS Ecke Kunststoff:31
- Flush:217: P150 1500mm:16 ↔ APS Ecke Kunststoff:32
- Flush:218: P150 1500mm:16 ↔ APS Ecke Kunststoff:32
- Flush:219: APS Ecke Kunststoff:30 ↔ P150 1200mm:16
- Flush:220: APS Ecke Kunststoff:30 ↔ P150 1200mm:16
- Mate:93: APS Ecke Kunststoff:28 ↔ P150 1200mm:16
- Flush:221: APS Ecke Kunststoff:28 ↔ P150 1200mm:16
- Flush:222: APS Ecke Kunststoff:28 ↔ P150 1200mm:16
- Flush:223: APS Ecke Kunststoff:27 ↔ P150 1200mm:15
- Flush:224: APS Ecke Kunststoff:27 ↔ P150 1200mm:15
- Mate:94: APS Ecke Kunststoff:17 ↔ APS Ecke Kunststoff:27
- Flush:225: APS Ecke Kunststoff:17 ↔ APS Ecke Kunststoff:27
- Flush:226: APS Ecke Kunststoff:17 ↔ APS Ecke Kunststoff:27
- Mate:95: APS Ecke Kunststoff:33 ↔ P150 2000mm:17
- Flush:227: APS Ecke Kunststoff:33 ↔ P150 2000mm:17
- Flush:228: APS Ecke Kunststoff:33 ↔ P150 2000mm:17
- Mate:96: APS Ecke Kunststoff:33 ↔ P150 1200mm:17
- Flush:229: APS Ecke Kunststoff:33 ↔ P150 1200mm:17
- Flush:230: APS Ecke Kunststoff:33 ↔ P150 1200mm:17
- Flush:231: APS Ecke Kunststoff:33 ↔ P150 1500mm:17
- Flush:232: APS Ecke Kunststoff:33 ↔ P150 1500mm:17
- Mate:97: APS Ecke Kunststoff:33 ↔ P150 1500mm:17
- Mate:98: APS Ecke Kunststoff:34 ↔ P150 2000mm:18
- Flush:233: APS Ecke Kunststoff:34 ↔ P150 2000mm:18
- Flush:234: APS Ecke Kunststoff:34 ↔ P150 2000mm:18
- Mate:99: APS Ecke Kunststoff:34 ↔ P150 1200mm:18
- Flush:235: APS Ecke Kunststoff:34 ↔ P150 1200mm:18
- Flush:236: APS Ecke Kunststoff:34 ↔ P150 1200mm:18
- Flush:237: APS Ecke Kunststoff:34 ↔ P150 1500mm:18
- Flush:238: APS Ecke Kunststoff:34 ↔ P150 1500mm:18
- Mate:100: APS Ecke Kunststoff:34 ↔ P150 1500mm:18
- Mate:101: P150 2000mm:17 ↔ APS Ecke Kunststoff:36
- Flush:239: P150 2000mm:17 ↔ APS Ecke Kunststoff:36
- Flush:240: P150 2000mm:17 ↔ APS Ecke Kunststoff:36
- Flush:241: P150 1500mm:17 ↔ APS Ecke Kunststoff:35
- Flush:242: P150 1500mm:17 ↔ APS Ecke Kunststoff:35
- Mate:102: P150 1500mm:17 ↔ APS Ecke Kunststoff:35
- Flush:243: P150 2000mm:18 ↔ APS Ecke Kunststoff:35
- Flush:244: P150 2000mm:18 ↔ APS Ecke Kunststoff:35
- Flush:245: P150 1500mm:18 ↔ APS Ecke Kunststoff:36
- Flush:246: P150 1500mm:18 ↔ APS Ecke Kunststoff:36
- Mate:103: APS Ecke Kunststoff:37 ↔ P150 2000mm:19
- Flush:247: APS Ecke Kunststoff:37 ↔ P150 2000mm:19
- Flush:248: APS Ecke Kunststoff:37 ↔ P150 2000mm:19
- Mate:104: APS Ecke Kunststoff:37 ↔ P150 1200mm:19
- Flush:249: APS Ecke Kunststoff:37 ↔ P150 1200mm:19
- Flush:250: APS Ecke Kunststoff:37 ↔ P150 1200mm:19
- Flush:251: APS Ecke Kunststoff:37 ↔ P150 1500mm:19
- Flush:252: APS Ecke Kunststoff:37 ↔ P150 1500mm:19
- Mate:105: APS Ecke Kunststoff:37 ↔ P150 1500mm:19
- Mate:106: APS Ecke Kunststoff:38 ↔ P150 2000mm:20
- Flush:253: APS Ecke Kunststoff:38 ↔ P150 2000mm:20
- Flush:254: APS Ecke Kunststoff:38 ↔ P150 2000mm:20
- Mate:107: APS Ecke Kunststoff:38 ↔ P150 1200mm:20
- Flush:255: APS Ecke Kunststoff:38 ↔ P150 1200mm:20
- Flush:256: APS Ecke Kunststoff:38 ↔ P150 1200mm:20
- Flush:257: APS Ecke Kunststoff:38 ↔ P150 1500mm:20
- Flush:258: APS Ecke Kunststoff:38 ↔ P150 1500mm:20
- Mate:108: APS Ecke Kunststoff:38 ↔ P150 1500mm:20
- Mate:109: P150 2000mm:19 ↔ APS Ecke Kunststoff:40
- Flush:259: P150 2000mm:19 ↔ APS Ecke Kunststoff:40
- Flush:260: P150 2000mm:19 ↔ APS Ecke Kunststoff:40
- Flush:261: P150 1500mm:19 ↔ APS Ecke Kunststoff:39
- Flush:262: P150 1500mm:19 ↔ APS Ecke Kunststoff:39
- Mate:110: P150 1500mm:19 ↔ APS Ecke Kunststoff:39
- Mate:111: P150 2000mm:20 ↔ APS Ecke Kunststoff:39
- Flush:263: P150 2000mm:20 ↔ APS Ecke Kunststoff:39
- Flush:264: P150 2000mm:20 ↔ APS Ecke Kunststoff:39
- Flush:265: P150 1500mm:20 ↔ APS Ecke Kunststoff:40
- Flush:266: P150 1500mm:20 ↔ APS Ecke Kunststoff:40
- Flush:267: APS Ecke Kunststoff:38 ↔ P150 1200mm:20
- Flush:268: APS Ecke Kunststoff:38 ↔ P150 1200mm:20
- Mate:112: APS Ecke Kunststoff:36 ↔ P150 1200mm:20
- Flush:269: APS Ecke Kunststoff:36 ↔ P150 1200mm:20
- Flush:270: APS Ecke Kunststoff:36 ↔ P150 1200mm:20
- Flush:271: APS Ecke Kunststoff:35 ↔ P150 1200mm:19
- Flush:272: APS Ecke Kunststoff:35 ↔ P150 1200mm:19
- Mate:113: APS Ecke Kunststoff:28 ↔ APS Ecke Kunststoff:33
- Flush:273: APS Ecke Kunststoff:28 ↔ APS Ecke Kunststoff:33
- Flush:274: APS Ecke Kunststoff:28 ↔ APS Ecke Kunststoff:33
- Mate:114: APS Ecke Kunststoff:41 ↔ P150 2000mm:21
- Flush:275: APS Ecke Kunststoff:41 ↔ P150 2000mm:21
- Flush:276: APS Ecke Kunststoff:41 ↔ P150 2000mm:21
- Mate:115: APS Ecke Kunststoff:41 ↔ P150 1200mm:21
- Flush:277: APS Ecke Kunststoff:41 ↔ P150 1200mm:21
- Flush:278: APS Ecke Kunststoff:41 ↔ P150 1200mm:21
- Flush:279: APS Ecke Kunststoff:41 ↔ P150 1500mm:21
- Flush:280: APS Ecke Kunststoff:41 ↔ P150 1500mm:21
- Mate:116: APS Ecke Kunststoff:41 ↔ P150 1500mm:21
- Mate:117: APS Ecke Kunststoff:42 ↔ P150 2000mm:22
- Flush:281: APS Ecke Kunststoff:42 ↔ P150 2000mm:22
- Flush:282: APS Ecke Kunststoff:42 ↔ P150 2000mm:22
- Mate:118: APS Ecke Kunststoff:42 ↔ P150 1200mm:22
- Flush:283: APS Ecke Kunststoff:42 ↔ P150 1200mm:22
- Flush:284: APS Ecke Kunststoff:42 ↔ P150 1200mm:22
- Flush:285: APS Ecke Kunststoff:42 ↔ P150 1500mm:22
- Flush:286: APS Ecke Kunststoff:42 ↔ P150 1500mm:22
- Mate:119: APS Ecke Kunststoff:42 ↔ P150 1500mm:22
- Mate:120: P150 2000mm:21 ↔ APS Ecke Kunststoff:44
- Flush:287: P150 2000mm:21 ↔ APS Ecke Kunststoff:44
- Flush:288: P150 2000mm:21 ↔ APS Ecke Kunststoff:44
- Flush:289: P150 1500mm:21 ↔ APS Ecke Kunststoff:43
- Flush:290: P150 1500mm:21 ↔ APS Ecke Kunststoff:43
- Mate:121: P150 1500mm:21 ↔ APS Ecke Kunststoff:43
- Flush:291: P150 2000mm:22 ↔ APS Ecke Kunststoff:43
- Flush:292: P150 2000mm:22 ↔ APS Ecke Kunststoff:43
- Flush:293: P150 1500mm:22 ↔ APS Ecke Kunststoff:44
- Flush:294: P150 1500mm:22 ↔ APS Ecke Kunststoff:44
- Mate:122: APS Ecke Kunststoff:45 ↔ P150 2000mm:23
- Flush:295: APS Ecke Kunststoff:45 ↔ P150 2000mm:23
- Flush:296: APS Ecke Kunststoff:45 ↔ P150 2000mm:23
- Mate:123: APS Ecke Kunststoff:45 ↔ P150 1200mm:23
- Flush:297: APS Ecke Kunststoff:45 ↔ P150 1200mm:23
- Flush:298: APS Ecke Kunststoff:45 ↔ P150 1200mm:23
- Flush:299: APS Ecke Kunststoff:45 ↔ P150 1500mm:23
- Flush:300: APS Ecke Kunststoff:45 ↔ P150 1500mm:23
- Mate:124: APS Ecke Kunststoff:45 ↔ P150 1500mm:23
- Mate:125: APS Ecke Kunststoff:46 ↔ P150 2000mm:24
- Flush:301: APS Ecke Kunststoff:46 ↔ P150 2000mm:24
- Flush:302: APS Ecke Kunststoff:46 ↔ P150 2000mm:24
- Mate:126: APS Ecke Kunststoff:46 ↔ P150 1200mm:24
- Flush:303: APS Ecke Kunststoff:46 ↔ P150 1200mm:24
- Flush:304: APS Ecke Kunststoff:46 ↔ P150 1200mm:24
- Flush:305: APS Ecke Kunststoff:46 ↔ P150 1500mm:24
- Flush:306: APS Ecke Kunststoff:46 ↔ P150 1500mm:24
- Mate:127: APS Ecke Kunststoff:46 ↔ P150 1500mm:24
- Mate:128: P150 2000mm:23 ↔ APS Ecke Kunststoff:48
- Flush:307: P150 2000mm:23 ↔ APS Ecke Kunststoff:48
- Flush:308: P150 2000mm:23 ↔ APS Ecke Kunststoff:48
- Flush:309: P150 1500mm:23 ↔ APS Ecke Kunststoff:47
- Flush:310: P150 1500mm:23 ↔ APS Ecke Kunststoff:47
- Mate:129: P150 1500mm:23 ↔ APS Ecke Kunststoff:47
- Mate:130: P150 2000mm:24 ↔ APS Ecke Kunststoff:47
- Flush:311: P150 2000mm:24 ↔ APS Ecke Kunststoff:47
- Flush:312: P150 2000mm:24 ↔ APS Ecke Kunststoff:47
- Flush:313: P150 1500mm:24 ↔ APS Ecke Kunststoff:48
- Flush:314: P150 1500mm:24 ↔ APS Ecke Kunststoff:48
- Flush:315: APS Ecke Kunststoff:46 ↔ P150 1200mm:24
- Flush:316: APS Ecke Kunststoff:46 ↔ P150 1200mm:24
- Mate:131: APS Ecke Kunststoff:44 ↔ P150 1200mm:24
- Flush:317: APS Ecke Kunststoff:44 ↔ P150 1200mm:24
- Flush:318: APS Ecke Kunststoff:44 ↔ P150 1200mm:24
- Flush:319: APS Ecke Kunststoff:43 ↔ P150 1200mm:23
- Flush:320: APS Ecke Kunststoff:43 ↔ P150 1200mm:23
- Mate:132: APS Ecke Kunststoff:25 ↔ APS Ecke Kunststoff:44
- Flush:321: APS Ecke Kunststoff:25 ↔ APS Ecke Kunststoff:44
- Flush:322: APS Ecke Kunststoff:25 ↔ APS Ecke Kunststoff:44
- Mate:133: P350 1210mm:5 ↔ Joint:9
- Flush:323: P350 1210mm:5 ↔ Joint:9
- Flush:324: P350 1210mm:5 ↔ Joint:9
- Flush:325: P350 1210mm:5 ↔ Joint:9
- Mate:134: P350 1210mm:5 ↔ Joint:10
- Flush:326: P350 1210mm:5 ↔ Joint:10
- Flush:327: P350 1210mm:5 ↔ Joint:10
- Mate:135: P150 2000mm:20 ↔ Joint:10
- Flush:328: P150 2000mm:20 ↔ P350 1210mm:5
- Mate:136 (980 mm): P150 1200mm:17 ↔ P350 1210mm:5
- Mate:137: P350 1210mm:6 ↔ Joint:11
- Flush:329: P350 1210mm:6 ↔ Joint:11
- Flush:330: P350 1210mm:6 ↔ Joint:11
- Flush:331: P350 1210mm:6 ↔ Joint:11
- Mate:138: P350 1210mm:6 ↔ Joint:12
- Flush:332: P350 1210mm:6 ↔ Joint:12
- Flush:333: P350 1210mm:6 ↔ Joint:12
- Flush:334: P150 2000mm:19 ↔ P350 1210mm:6
- Flush:335: P350 1210mm:5 ↔ P350 1210mm:6
- Mate:139: P150 2000mm:18 ↔ Joint:12
- Mate:140: P150 2000mm:20 ↔ P350 1550mm gefräst:5
- Flush:336: P150 2000mm:19 ↔ P350 1550mm gefräst:5
- Flush:337: P350 1210mm:5 ↔ P350 1550mm gefräst:5
- Mate:141: P150 2000mm:17 ↔ P350 1550mm gefräst:6
- Flush:338: P150 2000mm:17 ↔ P350 1550mm gefräst:6
- Flush:339: P350 1210mm:5 ↔ P350 1550mm gefräst:6
## Named parameters: d11_d0 = 0 mm, d12_d3 = 0 mm, d13_d4 = 0 mm, d14_d5 = 0 mm, d15_d6 = 0 mm, d16_d7 = 0 mm, d17_d8 = 0 mm, d18_d9 = 0 mm, d19_d10 = 0 mm, d33_d0 = 0 mm, d34_d3 = 0 mm, d35_d4 = 0 mm, d36_d5 = 0 mm, d37_d6 = 0 mm, d38_d7 = 0 mm, d39_d8 = 0 mm, d40_d9 = 0 mm, d41_d10 = 0 mm, d42_d11_d0 = 0 mm, d43_d12_d3 = 0 mm, d44_d13_d4 = 0 mm, d45_d14_d5 = 0 mm, d46_d15_d6 = 0 mm, d47_d16_d7 = 0 mm, d48_d17_d8 = 0 mm, d49_d18_d9 = 0 mm, d50_d19_d10 = 0 mm, d51_d20 = 0 mm, d52_d21 = 0 mm, d53_d22 = 0 mm, d54_d23 = 0 mm, d55_d24 = 0 mm, d56_d25 = 0 mm, d57_d26 = 0 mm, d58_d27 = 0 mm, d59_d28 = 0 mm, d60_d29 = 0 mm, d61_d30 = 0 mm, d62_d31 = 0 mm, d63_d32 = 0 mm, d79_d69 = 0 mm, d80_d70 = 0 mm, d81_d71 = 0 mm, d82_d72 = 0 mm, d83_d73 = 0 mm, d84_d74 = 0 mm, d85_d75 = 0 mm, d86_d69 = 0 mm, d87_d70 = 0 mm, d88_d71 = 0 mm, d89_d72 = 0 mm, d90_d73 = 0 mm, d91_d74 = 0 mm, d92_d75 = 0 mm, d93_d69 = 0 mm, d94_d70 = 0 mm, d95_d71 = 0 mm, d96_d72 = 0 mm, d97_d73 = 0 mm, d98_d74 = 0 mm, d99_d75 = 0 mm
